# Autodesk Inventor assembly: Assembly Roda 3 inch (s)
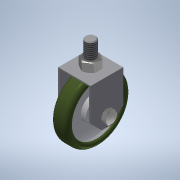
[picture p0: Inventor's stored thumbnail of the model, 180x180]
Saved by Autodesk Inventor 2020 (Build 240168000, 168)
## iProperties
Created: 2019-05-13
Part Number: Assembly Roda 3 inch (s)
Document SubType Name: Assembly
Designer: User
Author: User
## Documents named in this file (7)
- C:\Users\Haiqal Halqyonixh\Documents\My CAD\Wheel\Roda 3 inch (s)\Assembly Roda 3 inch (s).iam
- C:\Users\Haiqal Halqyonixh\Documents\My CAD\Wheel\Roda 3 inch (s)\Roda 3inch.ipt
- C:\Users\Haiqal Halqyonixh\Documents\My CAD\Wheel\Roda 3 inch (s)\Tapak Roda.ipt
- C:\Users\Haiqal Halqyonixh\Documents\My CAD\Wheel\Roda 3 inch (s)\Shaft Roda.ipt
- C:\Users\Haiqal Halqyonixh\Documents\Inventor\Content Center Files\R2020\en-US\ISO 4017(1)\ISO 4017 - M8 x 45 - ISO.ipt
- C:\Users\Haiqal Halqyonixh\Documents\Inventor\Content Center Files\R2020\en-US\ISO 4032(2)\ISO 4032 - M8 - ISO.ipt
- C:\Users\Haiqal Halqyonixh\Documents\Inventor\Content Center Files\R2020\en-US\ISO 4032(2)\ISO 4032 - M12 - ISO.ipt
## Components (6 placed, 6 different names)
1. Roda 3inch:1 — Mate:1, Mate:2
2. Tapak Roda:1 — Mate:1, Mate:2, Mate:3, Mate:4, Mate:5, Mate:6, Mate:7, Mate:10
3. Shaft Roda:1 — Mate:3, Mate:4, Mate:9
4. ISO 4017 M8 x 45:1 — Mate:5, Mate:6, Mate:8
5. ISO 4032 M8:1 — Mate:7, Mate:8
6. ISO 4032 M12:1 — Mate:9, Mate:10
## Relationships (10: Mate 10)
- Mate:1: Roda 3inch:1 ↔ Tapak Roda:1
- Mate:2 (7.55 mm): Roda 3inch:1 ↔ Tapak Roda:1
- Mate:3: Tapak Roda:1 ↔ Shaft Roda:1
- Mate:4: Tapak Roda:1 ↔ Shaft Roda:1
- Mate:5: Tapak Roda:1 ↔ ISO 4017 M8 x 45:1
- Mate:6: Tapak Roda:1 ↔ ISO 4017 M8 x 45:1
- Mate:7: Tapak Roda:1 ↔ ISO 4032 M8:1
- Mate:8: ISO 4017 M8 x 45:1 ↔ ISO 4032 M8:1
- Mate:9: Shaft Roda:1 ↔ ISO 4032 M12:1
- Mate:10: Tapak Roda:1 ↔ ISO 4032 M12:1
